# Autodesk Inventor assembly: Suporte Perfil
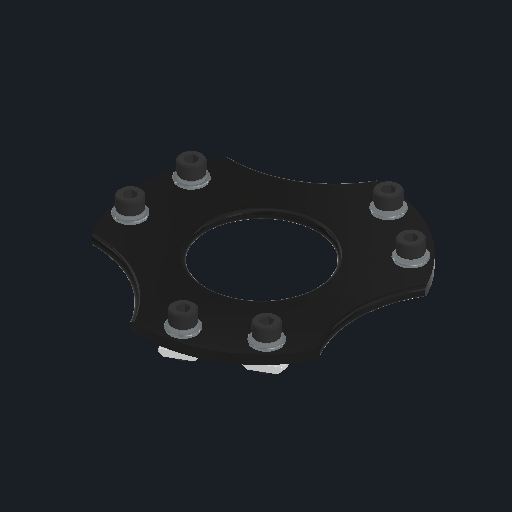
[picture p0: Inventor's stored thumbnail of the model, 512x512]
Saved by Autodesk Inventor 2026.1 (Build 301233000, 233)
## iProperties
Created: 2025-02-18
Part Number: Suporte Perfil
Document SubType Name: Assembly
Designer: Cliente
Mass: 29.5433 g
Surface Area: 125.784 cm^2
Volume: 12.5223 cm^3
Density: 2.35926 g/cm^3
Author: Cliente
## Documents named in this file (6)
- C:\Users\Cliente\Desktop\TCC\Fixação\Suporte perfil.iam
- C:\Users\Cliente\Desktop\TCC\Base\Impresso\Suporte perfil.ipt
- C:\Users\Cliente\Desktop\TCC\Fixação\Porca martelo M4 canal 6.ipt
- C:\Users\Cliente\Desktop\TCC\Fixação\Arruela Lisa DIN 125 - B4 - 300 HV.ipt
- C:\Users\Cliente\Desktop\TCC\Fixação\Arruela de Pressão DIN 127 - B4.ipt
- C:\Users\Cliente\Desktop\TCC\Fixação\Parafuso Allen Cabeça Cilíndrica DIN 912 - M4 - 12.9.ipt
## Components (25 placed, 5 different names)
1. Suporte perfil:1 — Alinhado:1, Alinhado:2, Alinhado:3, Coincidente:1, Coincidente:2, Coincidente:8
2. Parafuso Allen Cabeça Cilíndrica DIN 912 - M4 - 12.9:1 — Coincidente:5, Coincidente:6, Ângulo:3, Coincidente:7
3. Arruela de Pressão DIN 127 - B4:1 — Coincidente:3, Coincidente:4, Ângulo:2, Coincidente:5
4. Arruela Lisa DIN 125 - B4 - 300 HV:1 — Coincidente:1, Coincidente:2, Ângulo:1, Coincidente:3, Coincidente:4, Coincidente:6
5. Porca martelo M4 canal 6:1 — Coincidente:7, Coincidente:8, Ângulo:4
6. Parafuso Allen Cabeça Cilíndrica DIN 912 - M4 - 12.9:2
7. Arruela de Pressão DIN 127 - B4:2
8. Arruela Lisa DIN 125 - B4 - 300 HV:2
9. Porca martelo M4 canal 6:2
10. Parafuso Allen Cabeça Cilíndrica DIN 912 - M4 - 12.9:3
11. Arruela de Pressão DIN 127 - B4:3
12. Arruela Lisa DIN 125 - B4 - 300 HV:3
13. Porca martelo M4 canal 6:3
14. Parafuso Allen Cabeça Cilíndrica DIN 912 - M4 - 12.9:4
15. Arruela de Pressão DIN 127 - B4:4
16. Arruela Lisa DIN 125 - B4 - 300 HV:4
17. Porca martelo M4 canal 6:4
18. Parafuso Allen Cabeça Cilíndrica DIN 912 - M4 - 12.9:5
19. Arruela de Pressão DIN 127 - B4:5
20. Arruela Lisa DIN 125 - B4 - 300 HV:5
21. Porca martelo M4 canal 6:5
22. Parafuso Allen Cabeça Cilíndrica DIN 912 - M4 - 12.9:6
23. Arruela de Pressão DIN 127 - B4:6
24. Arruela Lisa DIN 125 - B4 - 300 HV:6
25. Porca martelo M4 canal 6:6
## Component patterns: (3 elements), (2 elements, first: Parafuso Allen Cabeça Cilíndrica DIN 912 - M4 - 12.9:1 + Arruela de Pressão DIN 127 - B4:1 + Arruela Lisa DIN 125 - B4 - 300 HV:1 + Porca martelo M4 canal 6:1), Componente de padrão 3:2 (2 elements), Componente de padrão 3:3 (2 elements)
## Relationships (15: Mate 8, Angle 4, Flush 3)
- Alinhado:1 [Flush]: Suporte perfil:1
- Alinhado:2 [Flush]: Suporte perfil:1
- Alinhado:3 [Flush]: Suporte perfil:1
- Coincidente:1 [Mate]: Suporte perfil:1 ↔ Arruela Lisa DIN 125 - B4 - 300 HV:1
- Coincidente:2 [Mate]: Suporte perfil:1 ↔ Arruela Lisa DIN 125 - B4 - 300 HV:1
- Ângulo:1 [Angle] (0 deg): Arruela Lisa DIN 125 - B4 - 300 HV:1
- Coincidente:3 [Mate]: Arruela de Pressão DIN 127 - B4:1 ↔ Arruela Lisa DIN 125 - B4 - 300 HV:1
- Coincidente:4 [Mate]: Arruela de Pressão DIN 127 - B4:1 ↔ Arruela Lisa DIN 125 - B4 - 300 HV:1
- Ângulo:2 [Angle] (180 deg): Arruela de Pressão DIN 127 - B4:1
- Coincidente:5 [Mate]: Parafuso Allen Cabeça Cilíndrica DIN 912 - M4 - 12.9:1 ↔ Arruela de Pressão DIN 127 - B4:1
- Coincidente:6 [Mate]: Parafuso Allen Cabeça Cilíndrica DIN 912 - M4 - 12.9:1 ↔ Arruela Lisa DIN 125 - B4 - 300 HV:1
- Ângulo:3 [Angle] (0 deg): Parafuso Allen Cabeça Cilíndrica DIN 912 - M4 - 12.9:1
- Coincidente:7 [Mate]: Parafuso Allen Cabeça Cilíndrica DIN 912 - M4 - 12.9:1 ↔ Porca martelo M4 canal 6:1
- Coincidente:8 [Mate] (1.8 mm): Suporte perfil:1 ↔ Porca martelo M4 canal 6:1
- Ângulo:4 [Angle] (0 deg): Porca martelo M4 canal 6:1
